# Autodesk Inventor assembly: 플랫폼
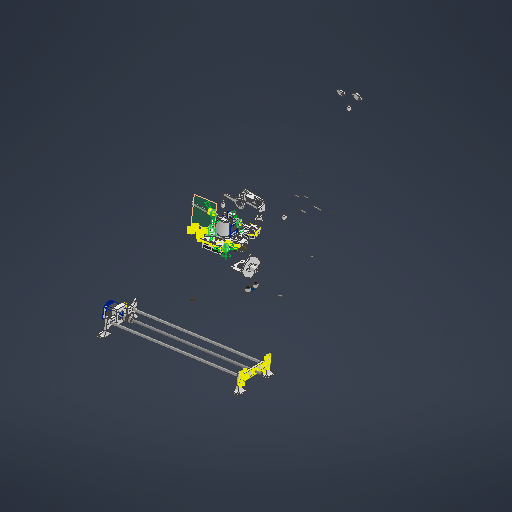
[picture p0: Inventor's stored thumbnail of the model, 512x512]
Saved by Autodesk Inventor 2026.2 (Build 302298000, 298)
## iProperties
Created: 2025-11-15
Part Number: 플랫폼
Document SubType Name: Assembly
Designer: work
Author: work
## Documents named in this file (49)
- C:\KHW\대학과제\CapStone_URProject\Object\플랫폼.iam
- C:\KHW\대학과제\CapStone_URProject\UR_tilt_v3\UR_tilt_Bparts_v3.ipt
- C:\KHW\대학과제\CapStone_URProject\UR_tilt_v3\UR_tilt_coupler_v1.ipt
- C:\KHW\대학과제\CapStone_URProject\UR_tilt_v3\UR_tilt_D_v3\UR_tilt_stand_v1.ipt
- C:\KHW\대학과제\CapStone_URProject\UR_tilt_v3\UR_tilt_D_v3\D1parts_v1.ipt
- C:\KHW\대학과제\CapStone_URProject\UR_tilt_v3\UR_tilt_D_v3\D2parts_v1.ipt
- C:\KHW\대학과제\CapStone_URProject\UR_tilt_v3\UR_tilt_D_v3\D3parts_v1.ipt
- C:\KHW\대학과제\CapStone_URProject\UR_tilt_v3\UR_tilt_D_v3\UR_tilt_coupler_side_v1.ipt
- C:\KHW\대학과제\CapStone_URProject\Object\T8_LeadNut.ipt
- C:\KHW\대학과제\CapStone_URProject\Object\8T_ScrewShaft.ipt
- C:\KHW\대학과제\CapStone_URProject\Object\8T_Shaft.ipt
- C:\KHW\대학과제\CapStone_URProject\Object\HC-SR04.ipt
- C:\KHW\대학과제\CapStone_URProject\Object\IRremote_ReceivingSensor.ipt
- C:\KHW\대학과제\CapStone_URProject\Object\LeadWay.ipt
- C:\KHW\대학과제\CapStone_URProject\Object\LimitedSwitch.ipt
- C:\KHW\대학과제\CapStone_URProject\Object\NEMA17.ipt
- C:\KHW\대학과제\CapStone_URProject\Object\T8_BellowsCoulping.ipt
- C:\KHW\대학과제\CapStone_URProject\UR_rail_v1\UR_rail_ScrewEnder_v1.ipt
- C:\KHW\대학과제\CapStone_URProject\UR_rail_v1\UR_rail_AxisEnder_v1.ipt
- C:\KHW\대학과제\CapStone_URProject\UR_rail_v1\UR_rail_AxisHolder_ScrewsCap12mm_v1.ipt
- C:\KHW\대학과제\CapStone_URProject\UR_rail_v1\UR_rail_AxisHolderBack_v1.ipt
- C:\KHW\대학과제\CapStone_URProject\UR_rail_v1\UR_rail_L_AxisHolder_v1.ipt
- C:\KHW\대학과제\CapStone_URProject\UR_rail_v1\UR_rail_LeadNutHolder_v1.ipt
- C:\KHW\대학과제\CapStone_URProject\UR_rail_v1\UR_rail_MH8_Holder_v1.ipt
- C:\KHW\대학과제\CapStone_URProject\UR_rail_v1\UR_rail_MorterBox_v1.ipt
- C:\KHW\대학과제\CapStone_URProject\UR_rail_v1\UR_rail_R_AxisHolder_v1.ipt
- C:\KHW\대학과제\CapStone_URProject\UR_rail_v1\UR_rail_R_LinearWayCopler_v3.ipt
- C:\KHW\대학과제\CapStone_URProject\UR_rail_v1\Not_Output\UR_rail_AxisHolder_ScrewsCap12mm_v1.ipt
- C:\KHW\대학과제\CapStone_URProject\UR_tilt_v4\UR_Base_v1.ipt
- C:\KHW\대학과제\CapStone_URProject\UR_tilt_v4\UR_rail_LinearWay_RSholder_v2.ipt
- C:\KHW\대학과제\CapStone_URProject\UR_tilt_v4\UR_ReflectivePlate_v1.ipt
- C:\KHW\대학과제\CapStone_URProject\Object\KS B 1003 - M 3 x 10.ipt
- C:\KHW\대학과제\CapStone_URProject\Object\KS B 1003 - M 3 x 30.ipt
- C:\KHW\대학과제\CapStone_URProject\Object\KS B 1003 - M 3 x 16.ipt
- C:\Users\work\Documents\Inventor\Content Center Files\R2026\ko-KR\KS B 1003\KS B 1003 - M 3 x 20.ipt
- C:\KHW\대학과제\CapStone_URProject\Object\KS B 1003 - M 3 x 25.ipt
- C:\KHW\대학과제\CapStone_URProject\Object\KS B 1012 - B  M 3.ipt
- C:\KHW\대학과제\CapStone_URProject\Object\KS B 1326 - 3x7 - 101.ipt
- C:\KHW\대학과제\CapStone_URProject\Object\KS B 1023 - A  M 2 x 5 - H(1).ipt
- C:\KHW\대학과제\CapStone_URProject\Object\KS B 1003 - M 2 x 16.ipt
- C:\KHW\대학과제\CapStone_URProject\Object\KS B 1012 - B  M 2.ipt
- C:\KHW\대학과제\CapStone_URProject\Object\T8_LeadNut_MIR.ipt
- C:\KHW\대학과제\CapStone_URProject\Object\LeadWay_MIR.ipt
- C:\KHW\대학과제\CapStone_URProject\Object\LimitedSwitch_MIR.ipt
- C:\KHW\대학과제\CapStone_URProject\UR_rail_v1\UR_rail_LeadNutHolder_v1_MIR.ipt
- C:\KHW\대학과제\CapStone_URProject\UR_rail_v1\UR_rail_R_LinearWayCopler_v3_MIR.ipt
- C:\KHW\대학과제\CapStone_URProject\UR_tilt_v4\UR_rail_LinearWay_RSholder_v2_MIR.ipt
- C:\KHW\대학과제\CapStone_URProject\Object\LeadWay_MIR1.ipt
- C:\KHW\대학과제\CapStone_URProject\UR_rail_v1\UR_rail_R_LinearWayCopler_v3_MIR1.ipt
## Components (156 placed, 47 different names)
1. UR_tilt_Bparts_v3:1 — 메이트:20, 메이트:21, 각도:6, 메이트:22, 메이트:23, 각도:7
2. UR_tilt_coupler_v1:1 — 메이트:22, 메이트:23, 각도:7, 메이트:24, 메이트:25
3. UR_tilt_stand_v1:1
4. D1parts_v1:1
5. D2parts_v1:1
6. D3parts_v1:1
7. UR_tilt_coupler_side_v1:1
8. T8_LeadNut:1 — 메이트:14, 메이트:15, 메이트:16, 회전:13, 회전:14, 회전:15, 회전:16
9. 8T_ScrewShaft:1 — 메이트:11
10. 8T_Shaft:1 — 메이트:7, 플러쉬:2, 메이트:9, 플러쉬:3
11. HC-SR04:1
12. IRremote_ReceivingSensor:1
13. LeadWay:1 — 메이트:17, 메이트:18, 메이트:19, 회전:5, 회전:6, 회전:7, 회전:8
14. LimitedSwitch:1 — 메이트:37, 각도:8, 메이트:38, 회전:39, 회전:40
15. NEMA17:1 — 메이트:1, 메이트:2, 각도:1, 각도:2, 메이트:11, 메이트:12, 각도:5, 각도:11
16. T8_BellowsCoulping:1 — 메이트:12, 각도:5, 메이트:13
17. 8T_Shaft:2 — 메이트:8, 플러쉬:1, 메이트:10
18. NEMA17:2 — 메이트:39, 메이트:40, 각도:9, 플러쉬:4, 각도:11, 각도:13, 플러쉬:6
19. NEMA17:3 — 메이트:20, 메이트:21, 각도:6
20. UR_rail_ScrewEnder_v1:1
21. UR_rail_AxisEnder_v1:1
22. UR_rail_AxisHolder_ScrewsCap12mm_v1:1
23. UR_rail_AxisHolderBack_v1:1 — 메이트:9, 메이트:10, 플러쉬:3
24. UR_rail_L_AxisHolder_v1:1 — 메이트:3, 메이트:5, 각도:4, 메이트:7, 플러쉬:2
25. UR_rail_LeadNutHolder_v1:1 — 메이트:14, 메이트:15, 메이트:16, 메이트:28, 회전:17, 회전:18, 회전:19, 회전:20, 메이트:29, 메이트:30, 회전:26, 회전:29
26. UR_rail_MH8_Holder_v1:1 — 회전:89, 각도:13, 회전:90
27. UR_rail_MorterBox_v1:1 — 메이트:1, 메이트:2, 각도:1, 각도:2, 메이트:3, 메이트:4, 메이트:5, 메이트:6, 각도:3, 각도:4, 메이트:13, 각도:10
28. UR_rail_R_AxisHolder_v1:1 — 메이트:4, 메이트:6, 각도:3, 메이트:8, 플러쉬:1
29. UR_rail_R_LinearWayCopler_v3:1 — 메이트:17, 메이트:18, 메이트:19, 회전:1, 회전:2, 회전:3, 회전:4, 메이트:31, 메이트:32, 메이트:33, 회전:33, 회전:34, 플러쉬:5
30. UR_rail_AxisHolder_ScrewsCap12mm_v1:2
31. UR_Base_v1:1 — 메이트:28, 메이트:29, 메이트:30, 회전:25, 회전:28, 메이트:31, 메이트:32, 메이트:33, 메이트:34, 메이트:35, 메이트:36, 메이트:39, 메이트:40, 각도:9, 각도:10, 회전:79, 회전:80, 회전:81, 회전:82, 메이트:49, 회전:83, 회전:84, 회전:85, 회전:86, 회전:87, 회전:88, 회전:89, 회전:91, 회전:108, 메이트:54
32. UR_rail_LinearWay_RSholder_v2:1 — 메이트:34, 메이트:35, 메이트:36, 회전:31, 회전:32, 메이트:37, 각도:8, 메이트:38, 회전:37, 회전:38
33. UR_ReflectivePlate_v1:1
34. KS B 1003 - M 3 x 10:1
35. KS B 1003 - M 3 x 30:1
36. KS B 1003 - M 3 x 16:1
37. KS B 1003 - 미터 M 3 x 20:1
38. KS B 1003 - M 3 x 25:1
39. KS B 1003 - M 3 x 25:2 — 회전:1
40. KS B 1003 - M 3 x 25:3 — 회전:2
41. KS B 1003 - M 3 x 25:4 — 회전:3
42. KS B 1003 - M 3 x 25:5 — 회전:4
43. KS B 1012 - B  M 3:1 — 회전:12
44. KS B 1012 - B  M 3:2 — 회전:10
45. KS B 1012 - B  M 3:3 — 회전:9
46. KS B 1012 - B  M 3:4 — 회전:11
47. KS B 1326 - 3x7 - 101:1 — 회전:6, 회전:10
48. KS B 1326 - 3x7 - 101:2 — 회전:7, 회전:12
49. KS B 1326 - 3x7 - 101:3 — 회전:8, 회전:11
50. KS B 1326 - 3x7 - 101:4 — 회전:5, 회전:9
51. KS B 1023 - A  M 2 x 5 - H(1):1 — 메이트:24
52. KS B 1023 - A  M 2 x 5 - H(1):2 — 메이트:25
53. KS B 1003 - M 3 x 16:2 — 회전:25
54. KS B 1003 - M 3 x 16:3 — 회전:13
55. KS B 1003 - M 3 x 16:4 — 회전:16
56. KS B 1003 - M 3 x 16:5 — 회전:14
57. KS B 1003 - M 3 x 16:6 — 회전:15
58. KS B 1326 - 3x7 - 101:5 — 회전:17, 회전:23
59. KS B 1326 - 3x7 - 101:6 — 회전:18, 회전:21
60. KS B 1326 - 3x7 - 101:7 — 회전:19, 회전:22
61. KS B 1326 - 3x7 - 101:8 — 회전:20, 회전:24
62. KS B 1326 - 3x7 - 101:9
63. KS B 1012 - B  M 3:5 — 회전:23
64. KS B 1012 - B  M 3:6 — 회전:22
65. KS B 1012 - B  M 3:7 — 회전:21
66. KS B 1012 - B  M 3:8 — 회전:24
67. KS B 1003 - M 3 x 25:6
68. KS B 1003 - M 3 x 16:7
69. KS B 1326 - 3x7 - 101:10 — 회전:29, 회전:30
70. KS B 1326 - 3x7 - 101:11 — 회전:26, 회전:27
71. KS B 1012 - B  M 3:9 — 회전:30
72. KS B 1012 - B  M 3:10 — 회전:27
73. KS B 1012 - B  M 3:11
74. KS B 1003 - M 3 x 16:8 — 회전:28
75. KS B 1003 - M 3 x 25:7 — 회전:31
76. KS B 1003 - M 3 x 25:8 — 회전:32
77. KS B 1326 - 3x7 - 101:12 — 회전:34, 회전:35
78. KS B 1326 - 3x7 - 101:13 — 회전:33, 회전:36
79. KS B 1012 - B  M 3:12 — 회전:35
80. KS B 1012 - B  M 3:13 — 회전:36
81. KS B 1003 - M 2 x 16:1 — 회전:37
82. KS B 1003 - M 2 x 16:2 — 회전:38
83. KS B 1012 - B  M 2:1 — 회전:39
84. KS B 1012 - B  M 2:2 — 회전:40
85. T8_LeadNut_MIR:1 — 메이트:41, 메이트:42, 메이트:43, 회전:53, 회전:54, 회전:55, 회전:56
86. LeadWay_MIR:1 — 메이트:44, 메이트:45, 메이트:46, 회전:46, 회전:48, 회전:50, 회전:52
87. LimitedSwitch_MIR:1 — 메이트:47, 각도:12, 메이트:48, 회전:77, 회전:78
88. UR_rail_LeadNutHolder_v1_MIR:1 — 메이트:41, 메이트:42, 메이트:43, 회전:57, 회전:58, 회전:59, 회전:60, 회전:65, 회전:66, 회전:82, 메이트:49
89. UR_rail_R_LinearWayCopler_v3_MIR:1 — 메이트:44, 메이트:45, 메이트:46, 회전:41, 회전:42, 회전:43, 회전:44, 회전:71, 회전:72, 회전:81, 플러쉬:5
90. UR_rail_LinearWay_RSholder_v2_MIR:1 — 메이트:47, 각도:12, 메이트:48, 회전:69, 회전:70, 회전:75, 회전:76, 회전:79, 회전:80
91. KS B 1003 - M 3 x 25:9 — 회전:41
92. KS B 1003 - M 3 x 25:10 — 회전:42
93. KS B 1003 - M 3 x 25:11 — 회전:43
94. KS B 1003 - M 3 x 25:12 — 회전:44
95. KS B 1012 - B  M 3:14 — 회전:47
96. KS B 1012 - B  M 3:15 — 회전:45
97. KS B 1012 - B  M 3:16 — 회전:51
98. KS B 1012 - B  M 3:17 — 회전:49
99. KS B 1326 - 3x7 - 101:14 — 회전:45, 회전:46
100. KS B 1326 - 3x7 - 101:15 — 회전:47, 회전:48
101. KS B 1326 - 3x7 - 101:16 — 회전:49, 회전:50
102. KS B 1326 - 3x7 - 101:17 — 회전:51, 회전:52
103. KS B 1003 - M 3 x 16:9 — 회전:84
104. KS B 1003 - M 3 x 16:10 — 회전:53
105. KS B 1003 - M 3 x 16:11 — 회전:54
106. KS B 1003 - M 3 x 16:12 — 회전:55
107. KS B 1003 - M 3 x 16:13 — 회전:56
108. KS B 1326 - 3x7 - 101:18 — 회전:57, 회전:61
109. KS B 1326 - 3x7 - 101:19 — 회전:58, 회전:63
110. KS B 1326 - 3x7 - 101:20 — 회전:59, 회전:62
111. KS B 1326 - 3x7 - 101:21 — 회전:60, 회전:64
112. KS B 1012 - B  M 3:18 — 회전:61
113. KS B 1012 - B  M 3:19 — 회전:62
114. KS B 1012 - B  M 3:20 — 회전:63
115. KS B 1012 - B  M 3:21 — 회전:64
116. KS B 1326 - 3x7 - 101:22 — 회전:65, 회전:67
117. KS B 1326 - 3x7 - 101:23 — 회전:66, 회전:68
118. KS B 1012 - B  M 3:22 — 회전:67
119. KS B 1012 - B  M 3:23 — 회전:68
120. KS B 1003 - M 3 x 16:14 — 회전:83
121. KS B 1003 - M 3 x 25:13 — 회전:69
122. KS B 1003 - M 3 x 25:14 — 회전:70
123. KS B 1326 - 3x7 - 101:24 — 회전:71, 회전:73
124. KS B 1326 - 3x7 - 101:25 — 회전:72, 회전:74
125. KS B 1012 - B  M 3:24 — 회전:73
126. KS B 1012 - B  M 3:25 — 회전:74
127. KS B 1003 - M 2 x 16:3 — 회전:75
128. KS B 1003 - M 2 x 16:4 — 회전:76
129. KS B 1012 - B  M 2:3 — 회전:77
130. KS B 1012 - B  M 2:4 — 회전:78
131. KS B 1003 - M 3 x 16:15 — 회전:87
132. KS B 1003 - M 3 x 16:16 — 회전:88
133. KS B 1003 - M 3 x 16:17 — 회전:86
134. KS B 1003 - M 3 x 16:18 — 회전:85
135. KS B 1003 - M 3 x 25:15 — 회전:90
136. UR_rail_MH8_Holder_v1:2 — 회전:91, 메이트:50
137. KS B 1003 - M 3 x 25:16 — 메이트:50
138. LeadWay_MIR1:1 — 메이트:51, 메이트:52, 메이트:53, 회전:97, 회전:99, 회전:101, 회전:103
139. UR_rail_R_LinearWayCopler_v3_MIR1:1 — 메이트:51, 메이트:52, 메이트:53, 회전:92, 회전:93, 회전:94, 회전:95, 회전:104, 회전:105, 회전:108
140. KS B 1003 - M 3 x 25:17 — 회전:92
141. KS B 1003 - M 3 x 25:18 — 회전:93
142. KS B 1003 - M 3 x 25:19 — 회전:94
143. KS B 1003 - M 3 x 25:20 — 회전:95
144. KS B 1012 - B  M 3:26 — 회전:98
145. KS B 1012 - B  M 3:27 — 회전:96
146. KS B 1012 - B  M 3:28 — 회전:102
147. KS B 1012 - B  M 3:29 — 회전:100
148. KS B 1326 - 3x7 - 101:26 — 회전:96, 회전:97
149. KS B 1326 - 3x7 - 101:27 — 회전:98, 회전:99
150. KS B 1326 - 3x7 - 101:28 — 회전:100, 회전:101
151. KS B 1326 - 3x7 - 101:29 — 회전:102, 회전:103
152. KS B 1326 - 3x7 - 101:30 — 회전:104, 회전:106
153. KS B 1326 - 3x7 - 101:31 — 회전:105, 회전:107
154. KS B 1012 - B  M 3:30 — 회전:106
155. KS B 1012 - B  M 3:31 — 회전:107
156. KS B 1003 - M 3 x 25:21 — 메이트:54
## Relationships (179: RevoluteJoint 108, Mate 52, Angle 13, Flush 6)
- 메이트:1 [Mate]: NEMA17:1 ↔ UR_rail_MorterBox_v1:1
- 메이트:2 [Mate]: NEMA17:1 ↔ UR_rail_MorterBox_v1:1
- 각도:1 [Angle] (0 deg): NEMA17:1 ↔ UR_rail_MorterBox_v1:1
- 각도:2 [Angle] (0 deg): NEMA17:1 ↔ UR_rail_MorterBox_v1:1
- 메이트:3 [Mate]: UR_rail_L_AxisHolder_v1:1 ↔ UR_rail_MorterBox_v1:1
- 메이트:4 [Mate]: UR_rail_MorterBox_v1:1 ↔ UR_rail_R_AxisHolder_v1:1
- 메이트:5 [Mate]: UR_rail_L_AxisHolder_v1:1 ↔ UR_rail_MorterBox_v1:1
- 메이트:6 [Mate]: UR_rail_MorterBox_v1:1 ↔ UR_rail_R_AxisHolder_v1:1
- 각도:3 [Angle] (0 deg): UR_rail_MorterBox_v1:1 ↔ UR_rail_R_AxisHolder_v1:1
- 각도:4 [Angle] (0 deg): UR_rail_L_AxisHolder_v1:1 ↔ UR_rail_MorterBox_v1:1
- 메이트:7 [Mate]: 8T_Shaft:1 ↔ UR_rail_L_AxisHolder_v1:1
- 메이트:8 [Mate]: 8T_Shaft:2 ↔ UR_rail_R_AxisHolder_v1:1
- 플러쉬:1 [Flush]: 8T_Shaft:2 ↔ UR_rail_R_AxisHolder_v1:1
- 플러쉬:2 [Flush]: 8T_Shaft:1 ↔ UR_rail_L_AxisHolder_v1:1
- 메이트:9 [Mate]: 8T_Shaft:1 ↔ UR_rail_AxisHolderBack_v1:1
- 메이트:10 [Mate]: 8T_Shaft:2 ↔ UR_rail_AxisHolderBack_v1:1
- 플러쉬:3 [Flush]: 8T_Shaft:1 ↔ UR_rail_AxisHolderBack_v1:1
- 메이트:11 [Mate]: 8T_ScrewShaft:1 ↔ NEMA17:1
- 메이트:12 [Mate]: NEMA17:1 ↔ T8_BellowsCoulping:1
- 각도:5 [Angle] (0 deg): NEMA17:1 ↔ T8_BellowsCoulping:1
- 메이트:13 [Mate] (10 mm): T8_BellowsCoulping:1 ↔ UR_rail_MorterBox_v1:1
- 메이트:14 [Mate]: T8_LeadNut:1 ↔ UR_rail_LeadNutHolder_v1:1
- 메이트:15 [Mate]: T8_LeadNut:1 ↔ UR_rail_LeadNutHolder_v1:1
- 메이트:16 [Mate]: T8_LeadNut:1 ↔ UR_rail_LeadNutHolder_v1:1
- 메이트:17 [Mate]: LeadWay:1 ↔ UR_rail_R_LinearWayCopler_v3:1
- 메이트:18 [Mate]: LeadWay:1 ↔ UR_rail_R_LinearWayCopler_v3:1
- 메이트:19 [Mate]: LeadWay:1 ↔ UR_rail_R_LinearWayCopler_v3:1
- 회전:1 [RevoluteJoint]: UR_rail_R_LinearWayCopler_v3:1 ↔ KS B 1003 - M 3 x 25:2
- 회전:2 [RevoluteJoint]: UR_rail_R_LinearWayCopler_v3:1 ↔ KS B 1003 - M 3 x 25:3
- 회전:3 [RevoluteJoint]: UR_rail_R_LinearWayCopler_v3:1 ↔ KS B 1003 - M 3 x 25:4
- 회전:4 [RevoluteJoint]: UR_rail_R_LinearWayCopler_v3:1 ↔ KS B 1003 - M 3 x 25:5
- 회전:5 [RevoluteJoint]: LeadWay:1 ↔ KS B 1326 - 3x7 - 101:4
- 회전:6 [RevoluteJoint]: LeadWay:1 ↔ KS B 1326 - 3x7 - 101:1
- 회전:7 [RevoluteJoint]: LeadWay:1 ↔ KS B 1326 - 3x7 - 101:2
- 회전:8 [RevoluteJoint]: LeadWay:1 ↔ KS B 1326 - 3x7 - 101:3
- 회전:9 [RevoluteJoint]: KS B 1012 - B  M 3:3 ↔ KS B 1326 - 3x7 - 101:4
- 회전:10 [RevoluteJoint]: KS B 1012 - B  M 3:2 ↔ KS B 1326 - 3x7 - 101:1
- 회전:11 [RevoluteJoint]: KS B 1012 - B  M 3:4 ↔ KS B 1326 - 3x7 - 101:3
- 회전:12 [RevoluteJoint]: KS B 1012 - B  M 3:1 ↔ KS B 1326 - 3x7 - 101:2
- 메이트:20 [Mate]: UR_tilt_Bparts_v3:1 ↔ NEMA17:3
- 메이트:21 [Mate]: UR_tilt_Bparts_v3:1 ↔ NEMA17:3
- 각도:6 [Angle] (0 deg): UR_tilt_Bparts_v3:1 ↔ NEMA17:3
- 메이트:22 [Mate]: UR_tilt_Bparts_v3:1 ↔ UR_tilt_coupler_v1:1
- 메이트:23 [Mate]: UR_tilt_Bparts_v3:1 ↔ UR_tilt_coupler_v1:1
- 각도:7 [Angle] (0 deg): UR_tilt_Bparts_v3:1 ↔ UR_tilt_coupler_v1:1
- 메이트:24 [Mate]: UR_tilt_coupler_v1:1 ↔ KS B 1023 - A  M 2 x 5 - H(1):1
- 메이트:25 [Mate]: UR_tilt_coupler_v1:1 ↔ KS B 1023 - A  M 2 x 5 - H(1):2
- 메이트:28 [Mate]: UR_rail_LeadNutHolder_v1:1 ↔ UR_Base_v1:1
- 회전:13 [RevoluteJoint]: T8_LeadNut:1 ↔ KS B 1003 - M 3 x 16:3
- 회전:14 [RevoluteJoint]: T8_LeadNut:1 ↔ KS B 1003 - M 3 x 16:5
- 회전:15 [RevoluteJoint]: T8_LeadNut:1 ↔ KS B 1003 - M 3 x 16:6
- 회전:16 [RevoluteJoint]: T8_LeadNut:1 ↔ KS B 1003 - M 3 x 16:4
- 회전:17 [RevoluteJoint]: UR_rail_LeadNutHolder_v1:1 ↔ KS B 1326 - 3x7 - 101:5
- 회전:18 [RevoluteJoint]: UR_rail_LeadNutHolder_v1:1 ↔ KS B 1326 - 3x7 - 101:6
- 회전:19 [RevoluteJoint]: UR_rail_LeadNutHolder_v1:1 ↔ KS B 1326 - 3x7 - 101:7
- 회전:20 [RevoluteJoint]: UR_rail_LeadNutHolder_v1:1 ↔ KS B 1326 - 3x7 - 101:8
- 회전:21 [RevoluteJoint]: KS B 1326 - 3x7 - 101:6 ↔ KS B 1012 - B  M 3:7
- 회전:22 [RevoluteJoint]: KS B 1326 - 3x7 - 101:7 ↔ KS B 1012 - B  M 3:6
- 회전:23 [RevoluteJoint]: KS B 1326 - 3x7 - 101:5 ↔ KS B 1012 - B  M 3:5
- 회전:24 [RevoluteJoint]: KS B 1326 - 3x7 - 101:8 ↔ KS B 1012 - B  M 3:8
- 메이트:29 [Mate]: UR_rail_LeadNutHolder_v1:1 ↔ UR_Base_v1:1
- 메이트:30 [Mate]: UR_rail_LeadNutHolder_v1:1 ↔ UR_Base_v1:1
- 회전:25 [RevoluteJoint]: UR_Base_v1:1 ↔ KS B 1003 - M 3 x 16:2
- 회전:26 [RevoluteJoint]: UR_rail_LeadNutHolder_v1:1 ↔ KS B 1326 - 3x7 - 101:11
- 회전:27 [RevoluteJoint]: KS B 1326 - 3x7 - 101:11 ↔ KS B 1012 - B  M 3:10
- 회전:28 [RevoluteJoint]: UR_Base_v1:1 ↔ KS B 1003 - M 3 x 16:8
- 회전:29 [RevoluteJoint]: UR_rail_LeadNutHolder_v1:1 ↔ KS B 1326 - 3x7 - 101:10
- 회전:30 [RevoluteJoint]: KS B 1326 - 3x7 - 101:10 ↔ KS B 1012 - B  M 3:9
- 메이트:31 [Mate]: UR_rail_R_LinearWayCopler_v3:1 ↔ UR_Base_v1:1
- 메이트:32 [Mate]: UR_rail_R_LinearWayCopler_v3:1 ↔ UR_Base_v1:1
- 메이트:33 [Mate]: UR_rail_R_LinearWayCopler_v3:1 ↔ UR_Base_v1:1
- 메이트:34 [Mate]: UR_Base_v1:1 ↔ UR_rail_LinearWay_RSholder_v2:1
- 메이트:35 [Mate]: UR_Base_v1:1 ↔ UR_rail_LinearWay_RSholder_v2:1
- 메이트:36 [Mate]: UR_Base_v1:1 ↔ UR_rail_LinearWay_RSholder_v2:1
- 회전:31 [RevoluteJoint]: UR_rail_LinearWay_RSholder_v2:1 ↔ KS B 1003 - M 3 x 25:7
- 회전:32 [RevoluteJoint]: UR_rail_LinearWay_RSholder_v2:1 ↔ KS B 1003 - M 3 x 25:8
- 회전:33 [RevoluteJoint]: UR_rail_R_LinearWayCopler_v3:1 ↔ KS B 1326 - 3x7 - 101:13
- 회전:34 [RevoluteJoint]: UR_rail_R_LinearWayCopler_v3:1 ↔ KS B 1326 - 3x7 - 101:12
- 회전:35 [RevoluteJoint]: KS B 1326 - 3x7 - 101:12 ↔ KS B 1012 - B  M 3:12
- 회전:36 [RevoluteJoint]: KS B 1326 - 3x7 - 101:13 ↔ KS B 1012 - B  M 3:13
- 메이트:37 [Mate]: LimitedSwitch:1 ↔ UR_rail_LinearWay_RSholder_v2:1
- 각도:8 [Angle] (0 deg): LimitedSwitch:1 ↔ UR_rail_LinearWay_RSholder_v2:1
- 메이트:38 [Mate]: LimitedSwitch:1 ↔ UR_rail_LinearWay_RSholder_v2:1
- 회전:37 [RevoluteJoint]: UR_rail_LinearWay_RSholder_v2:1 ↔ KS B 1003 - M 2 x 16:1
- 회전:38 [RevoluteJoint]: UR_rail_LinearWay_RSholder_v2:1 ↔ KS B 1003 - M 2 x 16:2
- 회전:39 [RevoluteJoint]: LimitedSwitch:1 ↔ KS B 1012 - B  M 2:1
- 회전:40 [RevoluteJoint]: LimitedSwitch:1 ↔ KS B 1012 - B  M 2:2
- 메이트:39 [Mate]: NEMA17:2 ↔ UR_Base_v1:1
- 메이트:40 [Mate]: NEMA17:2 ↔ UR_Base_v1:1
- 각도:9 [Angle] (0 deg): NEMA17:2 ↔ UR_Base_v1:1
- 플러쉬:4 [Flush] (-21.5 mm): NEMA17:2
- 각도:10 [Angle] (0 deg): UR_rail_MorterBox_v1:1 ↔ UR_Base_v1:1
- 각도:11 [Angle] (0 deg): NEMA17:1 ↔ NEMA17:2
- 메이트:41 [Mate]: T8_LeadNut_MIR:1 ↔ UR_rail_LeadNutHolder_v1_MIR:1
- 메이트:42 [Mate]: T8_LeadNut_MIR:1 ↔ UR_rail_LeadNutHolder_v1_MIR:1
- 메이트:43 [Mate]: T8_LeadNut_MIR:1 ↔ UR_rail_LeadNutHolder_v1_MIR:1
- 메이트:44 [Mate]: LeadWay_MIR:1 ↔ UR_rail_R_LinearWayCopler_v3_MIR:1
- 메이트:45 [Mate]: LeadWay_MIR:1 ↔ UR_rail_R_LinearWayCopler_v3_MIR:1
- 메이트:46 [Mate]: LeadWay_MIR:1 ↔ UR_rail_R_LinearWayCopler_v3_MIR:1
- 메이트:47 [Mate]: LimitedSwitch_MIR:1 ↔ UR_rail_LinearWay_RSholder_v2_MIR:1
- 각도:12 [Angle] (0 deg): LimitedSwitch_MIR:1 ↔ UR_rail_LinearWay_RSholder_v2_MIR:1
- 메이트:48 [Mate]: LimitedSwitch_MIR:1 ↔ UR_rail_LinearWay_RSholder_v2_MIR:1
- 회전:41 [RevoluteJoint]: UR_rail_R_LinearWayCopler_v3_MIR:1 ↔ KS B 1003 - M 3 x 25:9
- 회전:42 [RevoluteJoint]: UR_rail_R_LinearWayCopler_v3_MIR:1 ↔ KS B 1003 - M 3 x 25:10
- 회전:43 [RevoluteJoint]: UR_rail_R_LinearWayCopler_v3_MIR:1 ↔ KS B 1003 - M 3 x 25:11
- 회전:44 [RevoluteJoint]: UR_rail_R_LinearWayCopler_v3_MIR:1 ↔ KS B 1003 - M 3 x 25:12
- 회전:45 [RevoluteJoint]: KS B 1012 - B  M 3:15 ↔ KS B 1326 - 3x7 - 101:14
- 회전:46 [RevoluteJoint]: LeadWay_MIR:1 ↔ KS B 1326 - 3x7 - 101:14
- 회전:47 [RevoluteJoint]: KS B 1012 - B  M 3:14 ↔ KS B 1326 - 3x7 - 101:15
- 회전:48 [RevoluteJoint]: LeadWay_MIR:1 ↔ KS B 1326 - 3x7 - 101:15
- 회전:49 [RevoluteJoint]: KS B 1012 - B  M 3:17 ↔ KS B 1326 - 3x7 - 101:16
- 회전:50 [RevoluteJoint]: LeadWay_MIR:1 ↔ KS B 1326 - 3x7 - 101:16
- 회전:51 [RevoluteJoint]: KS B 1012 - B  M 3:16 ↔ KS B 1326 - 3x7 - 101:17
- 회전:52 [RevoluteJoint]: LeadWay_MIR:1 ↔ KS B 1326 - 3x7 - 101:17
- 회전:53 [RevoluteJoint]: T8_LeadNut_MIR:1 ↔ KS B 1003 - M 3 x 16:10
- 회전:54 [RevoluteJoint]: T8_LeadNut_MIR:1 ↔ KS B 1003 - M 3 x 16:11
- 회전:55 [RevoluteJoint]: T8_LeadNut_MIR:1 ↔ KS B 1003 - M 3 x 16:12
- 회전:56 [RevoluteJoint]: T8_LeadNut_MIR:1 ↔ KS B 1003 - M 3 x 16:13
- 회전:57 [RevoluteJoint]: UR_rail_LeadNutHolder_v1_MIR:1 ↔ KS B 1326 - 3x7 - 101:18
- 회전:58 [RevoluteJoint]: UR_rail_LeadNutHolder_v1_MIR:1 ↔ KS B 1326 - 3x7 - 101:19
- 회전:59 [RevoluteJoint]: UR_rail_LeadNutHolder_v1_MIR:1 ↔ KS B 1326 - 3x7 - 101:20
- 회전:60 [RevoluteJoint]: UR_rail_LeadNutHolder_v1_MIR:1 ↔ KS B 1326 - 3x7 - 101:21
- 회전:61 [RevoluteJoint]: KS B 1326 - 3x7 - 101:18 ↔ KS B 1012 - B  M 3:18
- 회전:62 [RevoluteJoint]: KS B 1326 - 3x7 - 101:20 ↔ KS B 1012 - B  M 3:19
- 회전:63 [RevoluteJoint]: KS B 1326 - 3x7 - 101:19 ↔ KS B 1012 - B  M 3:20
- 회전:64 [RevoluteJoint]: KS B 1326 - 3x7 - 101:21 ↔ KS B 1012 - B  M 3:21
- 회전:65 [RevoluteJoint]: UR_rail_LeadNutHolder_v1_MIR:1 ↔ KS B 1326 - 3x7 - 101:22
- 회전:66 [RevoluteJoint]: UR_rail_LeadNutHolder_v1_MIR:1 ↔ KS B 1326 - 3x7 - 101:23
- 회전:67 [RevoluteJoint]: KS B 1326 - 3x7 - 101:22 ↔ KS B 1012 - B  M 3:22
- 회전:68 [RevoluteJoint]: KS B 1326 - 3x7 - 101:23 ↔ KS B 1012 - B  M 3:23
- 회전:69 [RevoluteJoint]: UR_rail_LinearWay_RSholder_v2_MIR:1 ↔ KS B 1003 - M 3 x 25:13
- 회전:70 [RevoluteJoint]: UR_rail_LinearWay_RSholder_v2_MIR:1 ↔ KS B 1003 - M 3 x 25:14
- 회전:71 [RevoluteJoint]: UR_rail_R_LinearWayCopler_v3_MIR:1 ↔ KS B 1326 - 3x7 - 101:24
- 회전:72 [RevoluteJoint]: UR_rail_R_LinearWayCopler_v3_MIR:1 ↔ KS B 1326 - 3x7 - 101:25
- 회전:73 [RevoluteJoint]: KS B 1326 - 3x7 - 101:24 ↔ KS B 1012 - B  M 3:24
- 회전:74 [RevoluteJoint]: KS B 1326 - 3x7 - 101:25 ↔ KS B 1012 - B  M 3:25
- 회전:75 [RevoluteJoint]: UR_rail_LinearWay_RSholder_v2_MIR:1 ↔ KS B 1003 - M 2 x 16:3
- 회전:76 [RevoluteJoint]: UR_rail_LinearWay_RSholder_v2_MIR:1 ↔ KS B 1003 - M 2 x 16:4
- 회전:77 [RevoluteJoint]: LimitedSwitch_MIR:1 ↔ KS B 1012 - B  M 2:3
- 회전:78 [RevoluteJoint]: LimitedSwitch_MIR:1 ↔ KS B 1012 - B  M 2:4
- 회전:79 [RevoluteJoint]: UR_Base_v1:1 ↔ UR_rail_LinearWay_RSholder_v2_MIR:1
- 회전:80 [RevoluteJoint]: UR_Base_v1:1 ↔ UR_rail_LinearWay_RSholder_v2_MIR:1
- 회전:81 [RevoluteJoint]: UR_Base_v1:1 ↔ UR_rail_R_LinearWayCopler_v3_MIR:1
- 플러쉬:5 [Flush]: UR_rail_R_LinearWayCopler_v3:1 ↔ UR_rail_R_LinearWayCopler_v3_MIR:1
- 회전:82 [RevoluteJoint]: UR_Base_v1:1 ↔ UR_rail_LeadNutHolder_v1_MIR:1
- 메이트:49 [Mate]: UR_Base_v1:1 ↔ UR_rail_LeadNutHolder_v1_MIR:1
- 회전:83 [RevoluteJoint]: UR_Base_v1:1 ↔ KS B 1003 - M 3 x 16:14
- 회전:84 [RevoluteJoint]: UR_Base_v1:1 ↔ KS B 1003 - M 3 x 16:9
- 회전:85 [RevoluteJoint]: UR_Base_v1:1 ↔ KS B 1003 - M 3 x 16:18
- 회전:86 [RevoluteJoint]: UR_Base_v1:1 ↔ KS B 1003 - M 3 x 16:17
- 회전:87 [RevoluteJoint]: UR_Base_v1:1 ↔ KS B 1003 - M 3 x 16:15
- 회전:88 [RevoluteJoint]: UR_Base_v1:1 ↔ KS B 1003 - M 3 x 16:16
- 회전:89 [RevoluteJoint]: UR_rail_MH8_Holder_v1:1 ↔ UR_Base_v1:1
- 각도:13 [Angle] (-90 deg): NEMA17:2 ↔ UR_rail_MH8_Holder_v1:1
- 회전:90 [RevoluteJoint]: UR_rail_MH8_Holder_v1:1 ↔ KS B 1003 - M 3 x 25:15
- 회전:91 [RevoluteJoint]: UR_Base_v1:1 ↔ UR_rail_MH8_Holder_v1:2
- 메이트:50 [Mate]: UR_rail_MH8_Holder_v1:2 ↔ KS B 1003 - M 3 x 25:16
- 플러쉬:6 [Flush] (-21.5 mm): NEMA17:2
- 메이트:51 [Mate]: LeadWay_MIR1:1 ↔ UR_rail_R_LinearWayCopler_v3_MIR1:1
- 메이트:52 [Mate]: LeadWay_MIR1:1 ↔ UR_rail_R_LinearWayCopler_v3_MIR1:1
- 메이트:53 [Mate]: LeadWay_MIR1:1 ↔ UR_rail_R_LinearWayCopler_v3_MIR1:1
- 회전:92 [RevoluteJoint]: UR_rail_R_LinearWayCopler_v3_MIR1:1 ↔ KS B 1003 - M 3 x 25:17
- 회전:93 [RevoluteJoint]: UR_rail_R_LinearWayCopler_v3_MIR1:1 ↔ KS B 1003 - M 3 x 25:18
- 회전:94 [RevoluteJoint]: UR_rail_R_LinearWayCopler_v3_MIR1:1 ↔ KS B 1003 - M 3 x 25:19
- 회전:95 [RevoluteJoint]: UR_rail_R_LinearWayCopler_v3_MIR1:1 ↔ KS B 1003 - M 3 x 25:20
- 회전:96 [RevoluteJoint]: KS B 1012 - B  M 3:27 ↔ KS B 1326 - 3x7 - 101:26
- 회전:97 [RevoluteJoint]: LeadWay_MIR1:1 ↔ KS B 1326 - 3x7 - 101:26
- 회전:98 [RevoluteJoint]: KS B 1012 - B  M 3:26 ↔ KS B 1326 - 3x7 - 101:27
- 회전:99 [RevoluteJoint]: LeadWay_MIR1:1 ↔ KS B 1326 - 3x7 - 101:27
- 회전:100 [RevoluteJoint]: KS B 1012 - B  M 3:29 ↔ KS B 1326 - 3x7 - 101:28
- 회전:101 [RevoluteJoint]: LeadWay_MIR1:1 ↔ KS B 1326 - 3x7 - 101:28
- 회전:102 [RevoluteJoint]: KS B 1012 - B  M 3:28 ↔ KS B 1326 - 3x7 - 101:29
- 회전:103 [RevoluteJoint]: LeadWay_MIR1:1 ↔ KS B 1326 - 3x7 - 101:29
- 회전:104 [RevoluteJoint]: UR_rail_R_LinearWayCopler_v3_MIR1:1 ↔ KS B 1326 - 3x7 - 101:30
- 회전:105 [RevoluteJoint]: UR_rail_R_LinearWayCopler_v3_MIR1:1 ↔ KS B 1326 - 3x7 - 101:31
- 회전:106 [RevoluteJoint]: KS B 1326 - 3x7 - 101:30 ↔ KS B 1012 - B  M 3:30
- 회전:107 [RevoluteJoint]: KS B 1326 - 3x7 - 101:31 ↔ KS B 1012 - B  M 3:31
- 회전:108 [RevoluteJoint]: UR_Base_v1:1 ↔ UR_rail_R_LinearWayCopler_v3_MIR1:1
- 메이트:54 [Mate]: UR_Base_v1:1 ↔ KS B 1003 - M 3 x 25:21
